# Autodesk Inventor assembly: pat de mijloc 125x190
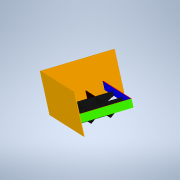
[picture p0: Inventor's stored thumbnail of the model, 180x180]
Saved by Autodesk Inventor 2022.6 (Build 266554000, 554)
## iProperties
Created: 2025-04-03
Part Number: pat de mijloc 125x190
Document SubType Name: Assembly
Designer: Dragos Macovei
Author: Dragos Macovei
## Documents named in this file (9)
- C:\Users\Dragos Macovei\Documents\Inventor_3d_parts\PAT\pat de colt.iam
- C:\Users\Dragos Macovei\Documents\Inventor_3d_parts\PAT\frontar.ipt
- C:\Users\Dragos Macovei\Documents\Inventor_3d_parts\PAT\laterala_stanga.ipt
- C:\Users\Dragos Macovei\Documents\Inventor_3d_parts\PAT\INTARITURA_FRONTAR.ipt
- C:\Users\Dragos Macovei\Documents\Inventor_3d_parts\PAT\intaritura_centru.ipt
- C:\Users\Dragos Macovei\Documents\Inventor_3d_parts\PAT\intaritura_spatare.ipt
- C:\Users\Dragos Macovei\Documents\Inventor_3d_parts\PAT\INTARITURA_STG_DR_pat_colt.ipt
- C:\Users\Dragos Macovei\Documents\Inventor_3d_parts\PAT\spatar_pat_colt.ipt
- C:\Users\Dragos Macovei\Documents\Inventor_3d_parts\PAT\laterala_pat_colt_spatar.ipt
## Components (12 placed, 8 different names)
1. frontar:1 — Flush:3, Flush:4, Mate:2, Flush:19, Mate:23, Mate:27, Mate:33
2. laterala_stanga:1 — Flush:3, Flush:4, Mate:2, Mate:20, Mate:21, Mate:28, Mate:29, Mate:32
3. INTARITURA_FRONTAR:1 — Flush:16, Flush:23, Mate:25, Mate:27, Flush:24
4. INTARITURA_FRONTAR:2 — Flush:17, Flush:19, Mate:23, Mate:24, Flush:21, Flush:24
5. intaritura_centru:1 — Flush:17, Flush:18, Mate:22, Mate:24, Flush:20, Flush:21
6. intaritura_centru:2 — Flush:15, Flush:16, Flush:22, Mate:25, Mate:26, Flush:25, Mate:30, Mate:31
7. intaritura_spatare:1 — Flush:15, Mate:20, Flush:22, Flush:23, Mate:26, Flush:26, Flush:29
8. intaritura_spatare:2 — Flush:18, Mate:21, Mate:22, Flush:20
9. INTARITURA_STG_DR_pat_colt:1 — Mate:29, Flush:25, Mate:30, Flush:31
10. INTARITURA_STG_DR_pat_colt:2 — Mate:28, Mate:31, Flush:26, Flush:28
11. spatar_pat_colt:1 — Mate:32, Flush:28, Flush:29, Flush:30, Mate:34
12. laterala_pat_colt_spatar:1 — Flush:30, Flush:31, Mate:33, Mate:34
## Relationships (34: Flush 18, Mate 16)
- Flush:3: frontar:1 ↔ laterala_stanga:1
- Flush:4: frontar:1 ↔ laterala_stanga:1
- Mate:2: frontar:1 ↔ laterala_stanga:1
- Flush:15: intaritura_centru:2 ↔ intaritura_spatare:1
- Flush:16: INTARITURA_FRONTAR:1 ↔ intaritura_centru:2
- Flush:17: INTARITURA_FRONTAR:2 ↔ intaritura_centru:1
- Flush:18: intaritura_centru:1 ↔ intaritura_spatare:2
- Mate:20 (400 mm): laterala_stanga:1 ↔ intaritura_spatare:1
- Mate:21 (846 mm): laterala_stanga:1 ↔ intaritura_spatare:2
- Mate:22 (18 mm): intaritura_centru:1 ↔ intaritura_spatare:2
- Flush:19 (100 mm): frontar:1 ↔ INTARITURA_FRONTAR:2
- Mate:23: frontar:1 ↔ INTARITURA_FRONTAR:2
- Mate:24 (18 mm): INTARITURA_FRONTAR:2 ↔ intaritura_centru:1
- Flush:20: intaritura_centru:1 ↔ intaritura_spatare:2
- Flush:21: INTARITURA_FRONTAR:2 ↔ intaritura_centru:1
- Flush:22: intaritura_centru:2 ↔ intaritura_spatare:1
- Flush:23: INTARITURA_FRONTAR:1 ↔ intaritura_spatare:1
- Mate:25 (18 mm): INTARITURA_FRONTAR:1 ↔ intaritura_centru:2
- Mate:26 (18 mm): intaritura_centru:2 ↔ intaritura_spatare:1
- Mate:27: frontar:1 ↔ INTARITURA_FRONTAR:1
- Flush:24: INTARITURA_FRONTAR:1 ↔ INTARITURA_FRONTAR:2
- Mate:28: laterala_stanga:1 ↔ INTARITURA_STG_DR_pat_colt:2
- Mate:29: laterala_stanga:1 ↔ INTARITURA_STG_DR_pat_colt:1
- Flush:25: intaritura_centru:2 ↔ INTARITURA_STG_DR_pat_colt:1
- Mate:30: intaritura_centru:2 ↔ INTARITURA_STG_DR_pat_colt:1
- Mate:31: intaritura_centru:2 ↔ INTARITURA_STG_DR_pat_colt:2
- Flush:26: intaritura_spatare:1 ↔ INTARITURA_STG_DR_pat_colt:2
- Mate:32: laterala_stanga:1 ↔ spatar_pat_colt:1
- Flush:28: INTARITURA_STG_DR_pat_colt:2 ↔ spatar_pat_colt:1
- Flush:29: intaritura_spatare:1 ↔ spatar_pat_colt:1
- Flush:30: spatar_pat_colt:1 ↔ laterala_pat_colt_spatar:1
- Flush:31: INTARITURA_STG_DR_pat_colt:1 ↔ laterala_pat_colt_spatar:1
- Mate:33: frontar:1 ↔ laterala_pat_colt_spatar:1
- Mate:34: spatar_pat_colt:1 ↔ laterala_pat_colt_spatar:1
